# Autodesk Inventor assembly: 2026-11-11-00-28-11-770
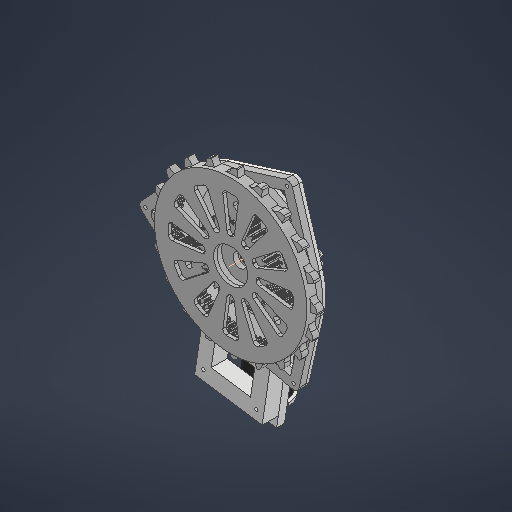
[picture p0: Inventor's stored thumbnail of the model, 512x512]
Saved by Autodesk Inventor 2027.1 (Build 311270010, 270A)
## iProperties
Created: 2026-11-10
Part Number: 2026-11-11-00-28-11-770
Document SubType Name: Assembly
Designer: AdminForWorker
Title: 無題 v1
Author: AdminForWorker
## Documents named in this file (11)
- D:\model\D2_Conveyor_2026\power_module\Paradox Planetary Gear Reducer\Gears\Assey_Paradox_Planetary_Gear_Power_Module\Gears.iam
- D:\model\D2_Conveyor_2026\power_module\Paradox Planetary Gear Reducer\Gears\Assey_Paradox_Planetary_Gear_Power_Module\太陽歯車 41T.ipt
- D:\model\D2_Conveyor_2026\power_module\Paradox Planetary Gear Reducer\Gears\Assey_Paradox_Planetary_Gear_Power_Module\遊星歯車 19T #1.ipt
- D:\model\D2_Conveyor_2026\power_module\Paradox Planetary Gear Reducer\Gears\Assey_Paradox_Planetary_Gear_Power_Module\固定内歯車 79T.ipt
- D:\model\D2_Conveyor_2026\power_module\Paradox Planetary Gear Reducer\Gears\Assey_Paradox_Planetary_Gear_Power_Module\出力内歯車 82T.ipt
- D:\model\D2_Conveyor_2026\power_module\Paradox Planetary Gear Reducer\Bearings\bearing_8_12.ipt
- D:\model\D2_Conveyor_2026\power_module\Paradox Planetary Gear Reducer\Bearings\Carer.ipt
- D:\model\D2_Conveyor_2026\power_module\Paradox Planetary Gear Reducer\Gears\M3_15_crown_out.ipt
- D:\model\D2_Conveyor_2026\power_module\Paradox Planetary Gear Reducer\Assey_Motors.iam
- D:\model\D2_Conveyor_2026\power_module\Paradox Planetary Gear Reducer\GearCover.ipt
- D:\model\D2_Conveyor_2026\power_module\Paradox Planetary Gear Reducer\Bearing_Fix.ipt
## Components (18 placed, 10 different names)
1. 遊星歯車 19T #1:1 — 回転:3, フラッシュ:1, 回転:13
2. bearing_8_12:1 — 回転:3, 回転:4
3. bearing_8_12:2 — 回転:6, 回転:11
4. bearing_8_12:4 — 回転:5, 回転:12
5. Assey_Motors:1 [sub-assembly] — メイト:9, メイト:10, メイト:11, メイト:12, メイト:22, 角度:1, メイト:32, メイト:33, メイト:34, 角度:2, メイト:40, 角度:3
6. M3_15_crown_out:1 — メイト:21, メイト:22, メイト:38
7. 太陽歯車 41T:1 — 回転:8, フラッシュ:1, メイト:21
8. bearing_8_12:5 — 回転:8, メイト:18
9. Carer:1 — 回転:4, 回転:5, 回転:6, メイト:16, 角度:1
10. 固定内歯車 79T:1 — メイト:17
11. 出力内歯車 82T:1 — メイト:16, メイト:17, メイト:18
12. GearCover:1 — フラッシュ:2, フラッシュ:3
13. 遊星歯車 19T #1:2 — 回転:11, 回転:14
14. 遊星歯車 19T #1:3 — 回転:12, 回転:15
15. Bearing_Fix:1 — 回転:15
16. Bearing_Fix:2
17. Bearing_Fix:3 — 回転:14
18. Bearing_Fix:4 — 回転:13
## Relationships (39: Mate 23, RevoluteJoint 10, Flush 3, Angle 3)
- 回転:3 [RevoluteJoint]: 遊星歯車 19T #1:1 ↔ bearing_8_12:1
- メイト:7 [Mate]
- メイト:8 [Mate]
- メイト:9 [Mate]: Assey_Motors:1
- メイト:10 [Mate]: Assey_Motors:1
- メイト:11 [Mate]: Assey_Motors:1
- メイト:12 [Mate]: Assey_Motors:1
- メイト:13 [Mate]
- メイト:14 [Mate]
- メイト:15 [Mate]
- 回転:4 [RevoluteJoint]: bearing_8_12:1 ↔ Carer:1
- 回転:5 [RevoluteJoint]: bearing_8_12:4 ↔ Carer:1
- 回転:6 [RevoluteJoint]: bearing_8_12:2 ↔ Carer:1
- メイト:16 [Mate]: Carer:1 ↔ 出力内歯車 82T:1
- メイト:17 [Mate]: 固定内歯車 79T:1 ↔ 出力内歯車 82T:1
- 回転:8 [RevoluteJoint]: 太陽歯車 41T:1 ↔ bearing_8_12:5
- メイト:18 [Mate]: bearing_8_12:5 ↔ 出力内歯車 82T:1
- フラッシュ:1 [Flush]: 遊星歯車 19T #1:1 ↔ 太陽歯車 41T:1
- メイト:21 [Mate]: M3_15_crown_out:1 ↔ 太陽歯車 41T:1
- メイト:22 [Mate]: Assey_Motors:1 ↔ M3_15_crown_out:1
- 角度:1 [Angle] (0 deg): Assey_Motors:1 ↔ Carer:1
- メイト:29 [Mate]
- メイト:30 [Mate]
- メイト:31 [Mate]
- メイト:32 [Mate]: Assey_Motors:1
- メイト:33 [Mate]: Assey_Motors:1
- メイト:34 [Mate]: Assey_Motors:1
- メイト:38 [Mate]: M3_15_crown_out:1
- メイト:39 [Mate]
- 角度:2 [Angle] (90 deg): Assey_Motors:1
- フラッシュ:2 [Flush]: GearCover:1
- フラッシュ:3 [Flush]: GearCover:1
- メイト:40 [Mate]: Assey_Motors:1
- 角度:3 [Angle] (0 deg): Assey_Motors:1
- 回転:11 [RevoluteJoint]: bearing_8_12:2 ↔ 遊星歯車 19T #1:2
- 回転:12 [RevoluteJoint]: bearing_8_12:4 ↔ 遊星歯車 19T #1:3
- 回転:13 [RevoluteJoint]: 遊星歯車 19T #1:1 ↔ Bearing_Fix:4
- 回転:14 [RevoluteJoint]: 遊星歯車 19T #1:2 ↔ Bearing_Fix:3
- 回転:15 [RevoluteJoint]: 遊星歯車 19T #1:3 ↔ Bearing_Fix:1
